# Autodesk Inventor assembly: 8108-8安装图
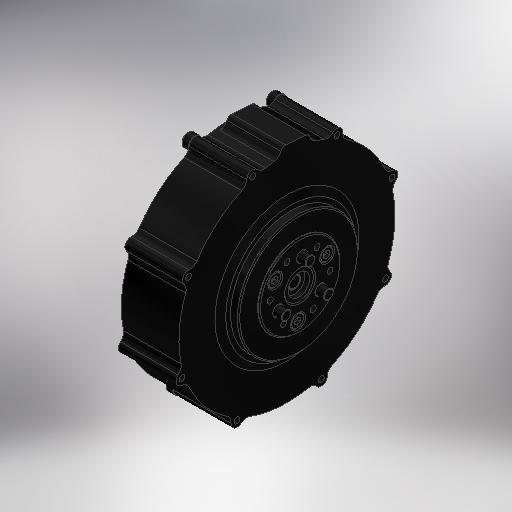
[picture p0: Inventor's stored thumbnail of the model, 512x512]
Saved by Autodesk Inventor 2025.3 (Build 293356030, 356C)
## iProperties
Created: 2024-04-22
Part Number: 8108-8安装图
Document SubType Name: Assembly
Designer: 8326d
Sending System: Autodesk Inventor 2024
Preprocessor: ST-DEVELOPER v19.2
Author: Admin
## Documents named in this file (3)
- C:\Users\ibuki_ono\Documents\hobby\rogiken\catchrobo\2026_CAD\Hardware_2026\Inventor\top_links\Steadywin-GIM8108-8\8108-8安装图.iam
- C:\Users\ibuki_ono\Documents\hobby\rogiken\catchrobo\2026_CAD\Hardware_2026\Inventor\top_links\Steadywin-GIM8108-8\8108-8_简化_1.ipt
- C:\Users\ibuki_ono\Documents\hobby\rogiken\catchrobo\2026_CAD\Hardware_2026\Inventor\top_links\Steadywin-GIM8108-8\V15驱动盖.ipt
## Components (2 placed, 2 different names)
1. 8108-8_简化_1:1 — メイト:1, メイト:2
2. V15驱动盖:1 — メイト:1, メイト:2
## Relationships (2: Mate 2)
- メイト:1 [Mate]: 8108-8_简化_1:1 ↔ V15驱动盖:1
- メイト:2 [Mate]: 8108-8_简化_1:1 ↔ V15驱动盖:1
